# Autodesk Inventor assembly: MM0861AN200_G22_824
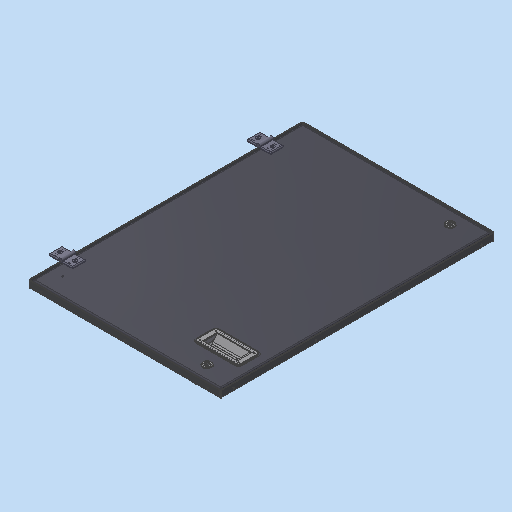
[picture p0: Inventor's stored thumbnail of the model, 512x512]
Saved by Autodesk Inventor 2023.3 (Build 273359000, 359)
## iProperties
Part Number: MM0861AN200_G22_824
Material: Generisch
Description: =<RBPARTNOTITLE2>
Document SubType Name: Assembly
Designer: Benutzer
Mass: 5860.06 g
Surface Area: 16518.5 cm^2
Volume: 1682.06 cm^3
Density: 3.48386 g/cm^3
RBCHANGEDESCRIPTION1: Erstfreigabe
RBCHANGENO1: 00
RBDOCUMENTTYPE: DRF
RBDOCUMENTVERSION: 00
RBDRAWINGMAINSCALE: 1:1
RBDRAWINGMISSINGSPEC: --
RBDRAWINGVOLUME: --
RBDSV1: 0850
RBGBDETAILS: 43274
RBGBEDGESIN1: +0,5
RBGBEDGESIN2: +0,2
RBGBEDGESOUT1: -0,3
RBGBEDGESOUT2: -0,1
RBMATERIAL: =<Material>
RBMATMEETS: --
RBMATNO: =<Part Number>
RBORGUNITRESPONSIBLE1: AnP/TEF1
RBPARTMADEOF: --
RBPARTNO: SIEHE MNR
RBPARTNOTITLE1: enter description here
RBPARTNOTITLE2: hier Bezeichnung eintragen
RBPARTSAFETYINDICATOR: --
RBSURFACE: --
RBSURFACE2: --
RBZEDGESNORM: ISO13715:2002-06
RBZGENDIMCLASS: m
RBZGENDIMNORM: ISO 2768-1:1989-11
RBZGENGEOCLASS: H
RBZGENGEONORM: ISO 2768-2:1989-11
RBZSURFACENORM: ISO13D2:2002-02
RBZTOLERANCENORM: ISO 14405-1:2010-12
AnP_Kommentar: --
MaxAbmaße: --
AnP_TemplVers: 20190222
AnP_Material: =<Material>
Author: Benutzer
Keywords: =<RBPARTMADEOF>
Comments: =<RBSURFACE2>
Revision Number: 01
## Documents named in this file (9)
- C:\Users\rea9an\Documents\Inventor\TCAI2412_te1910_EM\AS00000898.iam
- C:\Users\rea9an\Documents\Inventor\TCAI2412_te1910_EM\PT00004462.ipt
- C:\Users\rea9an\Documents\Inventor\TCAI2412_te1910_EM\PT00004461.ipt
- C:\Users\rea9an\Documents\Inventor\TCAI2412_te1910_EM\PT00004472.ipt
- C:\Users\rea9an\Documents\Inventor\TCAI2412_te1910_EM\PT00004316.ipt
- C:\Users\rea9an\Documents\Inventor\TCAI2412_te1910_EM\PT00004476.ipt
- C:\Users\rea9an\Documents\Inventor\TCAI2412_te1910_EM\PT00004477.ipt
- C:\Users\rea9an\Documents\Inventor\TCAI2412_te1910_EM\PT00004823.ipt
- C:\Users\rea9an\Documents\Inventor\TCAI2412_te1910_EM\PT00004779.ipt
## Components (16 placed, 8 different names)
1. PT00004462:1 — Passend:1, Fluchtend:1, Fluchtend:2, Passend:3, Fluchtend:7, Fluchtend:8, Fluchtend:11, Fluchtend:12, Fluchtend:13, Passend:8
2. PT00004461:1 — Passend:1, Fluchtend:1, Fluchtend:2, Fluchtend:3, Passend:2, Fluchtend:6, Passend:9, Passend:10, Passend:11, Passend:12, Passend:13, Passend:14, Einfügen:2, Einfügen:4, Einfügen:8, Einfügen:9
3. PT00004472:1 — Fluchtend:3, Passend:2, Passend:3
4. PT00004316:1 — Fluchtend:6, Fluchtend:7, Fluchtend:8, Fluchtend:9, Fluchtend:10
5. PT00004316:2 — Fluchtend:9, Fluchtend:10, Fluchtend:11
6. PT00004476:1 — Fluchtend:12, Fluchtend:13, Passend:8
7. PT00004477:1 — Passend:10, Passend:12, Passend:13
8. PT00004477:2 — Passend:9, Passend:11, Passend:14
9. PT00004823:1 — Einfügen:1
10. PT00004779:1 — Einfügen:1, Einfügen:2
11. PT00004823:2
12. PT00004779:2 — Einfügen:4
13. PT00004823:4
14. PT00004779:4 — Einfügen:8
15. PT00004823:5
16. PT00004779:5 — Einfügen:9
## Relationships (29: Flush 11, Mate 10, Insert 8)
- Passend:1 [Mate]: PT00004462:1 ↔ PT00004461:1
- Fluchtend:1 [Flush] (-7 mm): PT00004462:1 ↔ PT00004461:1
- Fluchtend:2 [Flush] (-7 mm): PT00004462:1 ↔ PT00004461:1
- Fluchtend:3 [Flush] (-2 mm): PT00004461:1 ↔ PT00004472:1
- Passend:2 [Mate] (130 mm): PT00004461:1 ↔ PT00004472:1
- Passend:3 [Mate] (525 mm): PT00004462:1 ↔ PT00004472:1
- Fluchtend:6 [Flush] (6 mm): PT00004461:1 ↔ PT00004316:1
- Fluchtend:7 [Flush] (-127 mm): PT00004462:1 ↔ PT00004316:1
- Fluchtend:8 [Flush] (2.5 mm): PT00004462:1 ↔ PT00004316:1
- Fluchtend:9 [Flush]: PT00004316:1 ↔ PT00004316:2
- Fluchtend:10 [Flush]: PT00004316:1 ↔ PT00004316:2
- Fluchtend:11 [Flush] (127 mm): PT00004462:1 ↔ PT00004316:2
- Fluchtend:12 [Flush] (-2 mm): PT00004462:1 ↔ PT00004476:1
- Fluchtend:13 [Flush] (-10 mm): PT00004462:1 ↔ PT00004476:1
- Passend:8 [Mate] (-5 mm): PT00004462:1 ↔ PT00004476:1
- Passend:9 [Mate]: PT00004461:1 ↔ PT00004477:2
- Passend:10 [Mate]: PT00004461:1 ↔ PT00004477:1
- Passend:11 [Mate] (0.1 mm): PT00004461:1 ↔ PT00004477:2
- Passend:12 [Mate] (0.1 mm): PT00004461:1 ↔ PT00004477:1
- Passend:13 [Mate] (0.1 mm): PT00004461:1 ↔ PT00004477:1
- Passend:14 [Mate] (0.1 mm): PT00004461:1 ↔ PT00004477:2
- Einfügen:1 [Insert]: PT00004823:1 ↔ PT00004779:1
- Einfügen:2 [Insert]: PT00004461:1 ↔ PT00004779:1
- [Insert]: PT00004823:2 ↔ PT00004779:2
- Einfügen:4 [Insert]: PT00004461:1 ↔ PT00004779:2
- [Insert]: PT00004823:4 ↔ PT00004779:4
- [Insert]: PT00004823:5 ↔ PT00004779:5
- Einfügen:8 [Insert]: PT00004461:1 ↔ PT00004779:4
- Einfügen:9 [Insert]: PT00004461:1 ↔ PT00004779:5
## Named parameters: d35_d33 = 0 mm, d38_d33 = 0 mm, d39_d33 = 0 mm
